# Autodesk Inventor assembly: Assembly1
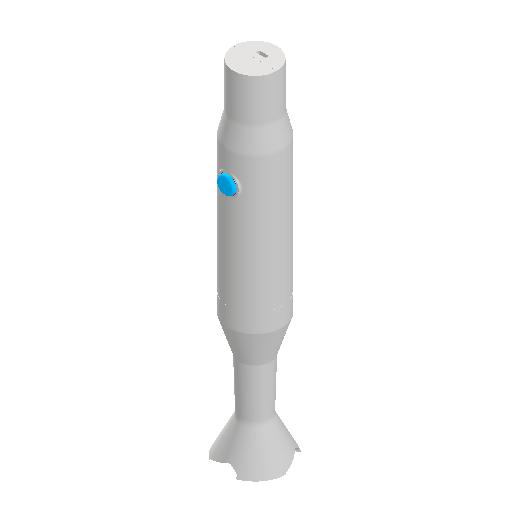
[picture p0: Inventor's stored thumbnail of the model, 512x512]
Saved by Autodesk Inventor 2027.1 (Build 311270010, 270A)
## iProperties
Created: 2026-10-20
Part Number: Assembly1
Document SubType Name: Assembly
Designer: MSIPC
Author: MSIPC
## Documents named in this file (11)
- C:\Users\MSIPC\Documents\Blender\Assembly1.iam
- C:\Users\MSIPC\Documents\Blender\Blender_Blade.ipt
- C:\Users\MSIPC\Documents\Blender\Blender_Lower Housing.ipt
- C:\Users\MSIPC\Documents\Blender\Battery_Holder\Battery_Holder.ipt
- C:\Users\MSIPC\Documents\Blender\193893265-9-3234846\3234846.ipt
- C:\Users\MSIPC\Documents\Blender\Blender_Upper Housing2.ipt
- C:\Users\MSIPC\Documents\Blender\Connector.ipt
- C:\Users\MSIPC\Documents\Blender\Cover.ipt
- C:\Users\MSIPC\Documents\Blender\Blender_Upper Housing1.ipt
- C:\Users\MSIPC\Documents\Blender\circuit_dummy.ipt
- C:\Users\MSIPC\Documents\Blender\Button.ipt
## Components (10 placed, 10 different names)
1. Blender_Blade:1 — Insert:1
2. Blender_Lower Housing:1 — Insert:1, Insert:8
3. Battery_Holder:1 — Insert:4, Mate:5
4. 3234846:1 — Insert:3
5. Blender_Upper Housing2:1 — Insert:3, Insert:4, Mate:5, Insert:5, Mate:6, Insert:6, Insert:7, Insert:8, Insert:9
6. Connector:1
7. Cover:1 — Insert:5, Mate:6, Insert:6
8. Blender_Upper Housing1:1 — Insert:7, Insert:10
9. circuit_dummy:1 — Insert:9
10. Button:1 — Insert:10
## Relationships (11: Insert 9, Mate 2)
- Insert:1 (-100 mm): Blender_Blade:1 ↔ Blender_Lower Housing:1
- Insert:3 (3 mm): 3234846:1 ↔ Blender_Upper Housing2:1
- Insert:4: Battery_Holder:1 ↔ Blender_Upper Housing2:1
- Mate:5: Battery_Holder:1 ↔ Blender_Upper Housing2:1
- Insert:5: Blender_Upper Housing2:1 ↔ Cover:1
- Mate:6: Blender_Upper Housing2:1 ↔ Cover:1
- Insert:6: Blender_Upper Housing2:1 ↔ Cover:1
- Insert:7: Blender_Upper Housing2:1 ↔ Blender_Upper Housing1:1
- Insert:8: Blender_Lower Housing:1 ↔ Blender_Upper Housing2:1
- Insert:9: Blender_Upper Housing2:1 ↔ circuit_dummy:1
- Insert:10 (-3 mm): Blender_Upper Housing1:1 ↔ Button:1
